# Autodesk Inventor assembly: parchute servo assembly
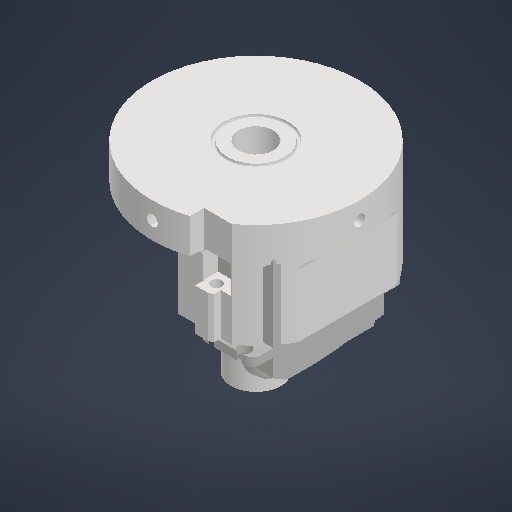
[picture p0: Inventor's stored thumbnail of the model, 512x512]
Saved by Autodesk Inventor 2027 (Build 310192060, 192F)
## iProperties
Created: 2026-11-04
Part Number: parchute servo assembly
Document SubType Name: Assembly
Designer: troop
Author: troop
## Documents named in this file (3)
- C:\Users\troop\OneDrive\Documents\Inventor\SpaceX Rocket\parchute servo assembly.iam
- C:\Users\troop\OneDrive\Documents\Inventor\SpaceX Rocket\Parachute Bulkhead_V4.ipt
- C:\Users\troop\OneDrive\Documents\KiCad\Rocket electronics\29KG_Servo_DS3218MG_2.ipt
## Components (2 placed, 2 different names)
1. Parachute Bulkhead_V4:1 — Mate:1
2. 29KG_Servo_DS3218MG_2:1 — Mate:1
## Relationships (1: Mate 1)
- Mate:1: Parachute Bulkhead_V4:1 ↔ 29KG_Servo_DS3218MG_2:1
